# Autodesk Inventor assembly: полигон
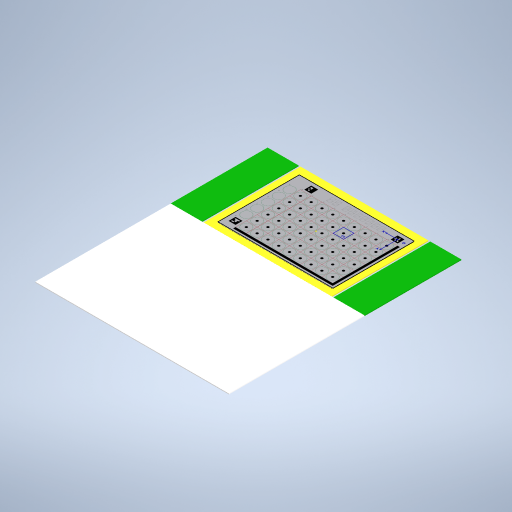
[picture p0: Inventor's stored thumbnail of the model, 512x512]
Saved by Autodesk Inventor 2024.2 (Build 282272000, 272)
## iProperties
Created: 2026-10-08
Part Number: полигон
Document SubType Name: Assembly
Designer: User
Author: User
## Documents named in this file (5)
- E:\ETZ_10\ETZ_10\construction\полигон\полигон.iam
- E:\ETZ_10\ETZ_10\construction\полигон\зона1.ipt
- E:\ETZ_10\ETZ_10\construction\полигон\зона2.ipt
- E:\ETZ_10\ETZ_10\construction\зона для листа.ipt
- E:\ETZ_10\ETZ_10\construction\полеигровое.ipt
## Components (4 placed, 4 different names)
1. зона1:1 — Заподлицо:1, Заподлицо:2, Заподлицо:4
2. зона2:1 — Заподлицо:1, Заподлицо:2, Заподлицо:3
3. зона для листа:1 — Заподлицо:3, Заподлицо:4, Заподлицо:5, Заподлицо:6
4. полеигровое:1 — Заподлицо:5, Заподлицо:6
## Relationships (6: Flush 6)
- Заподлицо:1 [Flush]: зона1:1 ↔ зона2:1
- Заподлицо:2 [Flush]: зона1:1 ↔ зона2:1
- Заподлицо:3 [Flush]: зона2:1 ↔ зона для листа:1
- Заподлицо:4 [Flush]: зона1:1 ↔ зона для листа:1
- Заподлицо:5 [Flush]: зона для листа:1 ↔ полеигровое:1
- Заподлицо:6 [Flush]: зона для листа:1 ↔ полеигровое:1
